# Autodesk Inventor assembly: Assembly V2
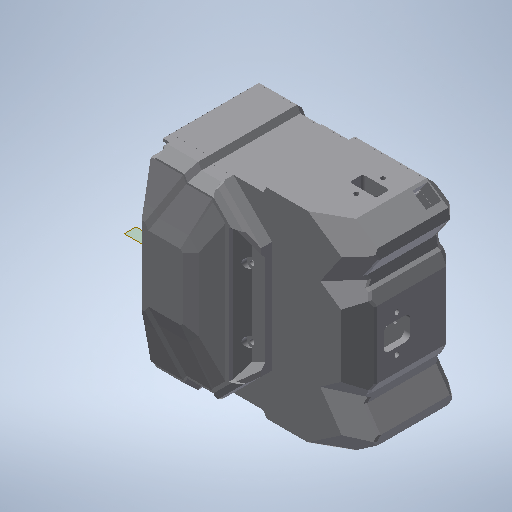
[picture p0: Inventor's stored thumbnail of the model, 512x512]
Saved by Autodesk Inventor 2025.2 (Build 292293000, 293)
## iProperties
Created: 2026-06-26
Part Number: Assembly V2
Document SubType Name: Assembly
Designer: crazi
Author: crazi
## Documents named in this file (5)
- D:\Family\Arav\Projects\Drone\Chassis\Custom Chassis\Modelled\Assembly V2.iam
- D:\Family\Arav\Projects\Drone\Chassis\Custom Chassis\Modelled\Bottom Cap V3 - Main V2.ipt
- D:\Family\Arav\Projects\Drone\Chassis\Custom Chassis\Modelled\Base Model V2.ipt
- D:\Family\Arav\Projects\Drone\Chassis\Custom Chassis\Modelled\Top Cap V2.ipt
- D:\Family\Arav\Projects\Drone\Chassis\Custom Chassis\Modelled\Bottom Cap V3 - Lower V2.ipt
## Components (4 placed, 4 different names)
1. Bottom Cap V3 - Main V2:1 — Mate:1, Mate:2, Mate:3, Mate:4, Flush:1, Flush:2, Mate:5, Flush:3, Flush:4
2. Base Model V2:1 — Mate:1, Mate:2, Mate:3
3. Top Cap V2:1 — Mate:4, Flush:1, Flush:2
4. Bottom Cap V3 - Lower V2:1 — Mate:5, Flush:3, Flush:4
## Relationships (9: Mate 5, Flush 4)
- Mate:1 (1 mm): Bottom Cap V3 - Main V2:1 ↔ Base Model V2:1
- Mate:2: Bottom Cap V3 - Main V2:1 ↔ Base Model V2:1
- Mate:3 (0.5 mm): Bottom Cap V3 - Main V2:1 ↔ Base Model V2:1
- Mate:4: Bottom Cap V3 - Main V2:1 ↔ Top Cap V2:1
- Flush:1: Bottom Cap V3 - Main V2:1 ↔ Top Cap V2:1
- Flush:2: Bottom Cap V3 - Main V2:1 ↔ Top Cap V2:1
- Mate:5: Bottom Cap V3 - Main V2:1 ↔ Bottom Cap V3 - Lower V2:1
- Flush:3: Bottom Cap V3 - Main V2:1 ↔ Bottom Cap V3 - Lower V2:1
- Flush:4: Bottom Cap V3 - Main V2:1 ↔ Bottom Cap V3 - Lower V2:1
